# Autodesk Inventor assembly: PROJECT_X.0001
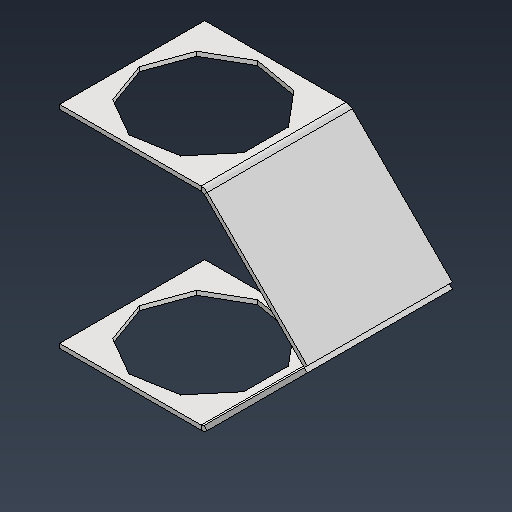
[picture p0: Inventor's stored thumbnail of the model, 512x512]
Saved by Autodesk Inventor 2026 (Build 300175000, 175)
## iProperties
RuleStatus: InUse
Manager: Летов
Company: ООО "МОЯ ОБОРОНА"
Created: 2026-10-15
Part Number: PROJECT_X.0001
Document SubType Name: Assembly
Designer: dmitrii.kriskovets
Checked By: Летов
Engr Approved By: Летов
Mfg Approved By: Летов
Authority: Летов
Mass: 83.9938 g
Surface Area: 612.409 cm^2
Volume: 83.9938 cm^3
Density: 1 g/cm^3
Author: Ивлев
Title: Сборка 1
## Documents named in this file (2)
- C:\Users\dmitrii.kriskovets\Desktop\it\5\IDPAM_1.0\project\PROJECT_X\0_Модели\PROJECT_X.0001 - Сборка 1.iam
- C:\Users\dmitrii.kriskovets\Desktop\it\5\IDPAM_1.0\project\PROJECT_X\0_Модели\PROJECT_X.0002 - Деталь 1.ipt
## Components (2 placed, 1 different names)
1. PROJECT_X.0002 - Деталь 1:1 — Совмещение:1, Угол:1, Заподлицо:1
2. PROJECT_X.0002 - Деталь 1:2 — Совмещение:1, Угол:1, Заподлицо:1
## Relationships (3: Mate 1, Angle 1, Flush 1)
- Совмещение:1 [Mate]: PROJECT_X.0002 - Деталь 1:1 ↔ PROJECT_X.0002 - Деталь 1:2
- Угол:1 [Angle] (180 deg): PROJECT_X.0002 - Деталь 1:1 ↔ PROJECT_X.0002 - Деталь 1:2
- Заподлицо:1 [Flush]: PROJECT_X.0002 - Деталь 1:1 ↔ PROJECT_X.0002 - Деталь 1:2
